# Autodesk Inventor assembly: result-composite
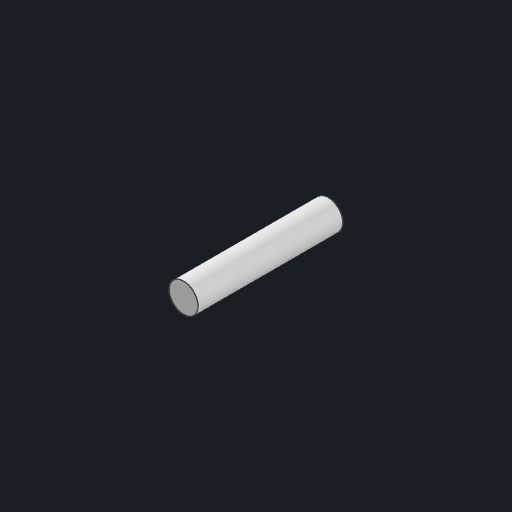
[picture p0: Inventor's stored thumbnail of the model, 512x512]
Saved by Autodesk Inventor 2026.1 (Build 301233000, 233)
## iProperties
Created: 2026-10-30
Part Number: result-composite
Document SubType Name: Assembly
Designer: anony
Author: anony
## Documents named in this file (2)
- C:\Users\anony\OneDrive\Desktop\AI Projects\CAD Convert\corpus\generated\asmimate\result-composite.iam
- C:\Users\anony\OneDrive\Desktop\AI Projects\CAD Convert\corpus\generated\imate\composite.ipt
## Components (2 placed, 1 different names)
1. composite:1
2. composite:2
## Relationships (1: Composite 1)
- [Composite]: composite:1 ↔ composite:2
